# Autodesk Inventor assembly: EG_Lampe
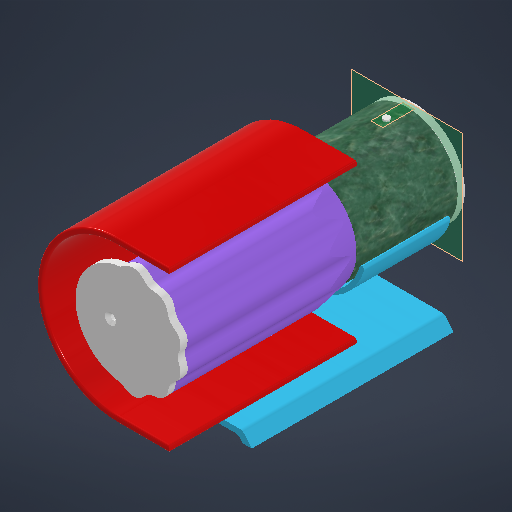
[picture p0: Inventor's stored thumbnail of the model, 512x512]
Saved by Autodesk Inventor 2026.1 (Build 301233020, 233B)
## iProperties
Created: 2025-11-26
Part Number: EG_Lampe
Document SubType Name: Assembly
Designer: matpo
Author: matpo
## Documents named in this file (8)
- C:\Users\matpo\Documents\projet\lampe\EG_Lampe.iam
- C:\Users\matpo\Documents\projet\lampe\socle_lumiere.ipt
- C:\Users\matpo\Documents\projet\lampe\corps.ipt
- C:\Users\matpo\Documents\projet\lampe\socle.ipt
- C:\Users\matpo\Documents\projet\lampe\couvercle.ipt
- C:\Users\matpo\Documents\projet\lampe\fermeture7.ipt
- C:\Users\matpo\OneDrive\Desktop\COUVERCLE2.ipt
- C:\Users\matpo\OneDrive\Desktop\bouton.ipt
## Components (7 placed, 7 different names)
1. socle_lumiere:1 — Affleurement:1, Affleurement:4
2. corps:1 — Affleurement:1, Affleurement:3, Affleurement:5, Affleurement:6, Affleurement:7
3. socle:1 — Affleurement:2
4. couvercle:1 — Affleurement:3
5. fermeture7:1 — Affleurement:4
6. COUVERCLE2:1 — Affleurement:5, Affleurement:6
7. bouton:1 — Affleurement:7
## Relationships (7: Flush 7)
- Affleurement:1 [Flush]: socle_lumiere:1 ↔ corps:1
- Affleurement:2 [Flush]: socle:1
- Affleurement:3 [Flush]: corps:1 ↔ couvercle:1
- Affleurement:4 [Flush]: socle_lumiere:1 ↔ fermeture7:1
- Affleurement:5 [Flush]: corps:1 ↔ COUVERCLE2:1
- Affleurement:6 [Flush]: corps:1 ↔ COUVERCLE2:1
- Affleurement:7 [Flush] (-5 mm): corps:1 ↔ bouton:1
